# Autodesk Inventor assembly: Camera_Mount_Assembly
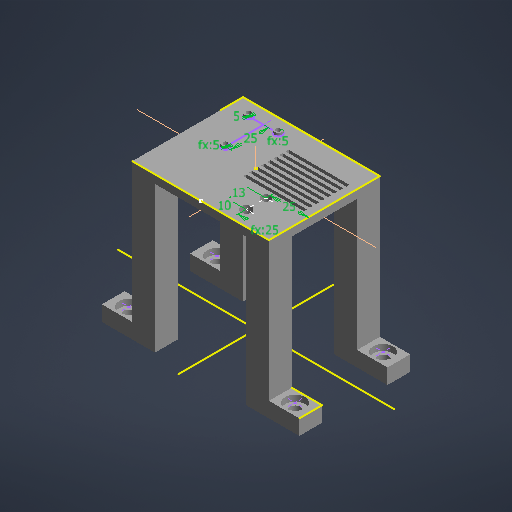
[picture p0: Inventor's stored thumbnail of the model, 512x512]
Saved by Autodesk Inventor 2027 (Build 310192000, 192)
## iProperties
Part Number: Camera_Mount_Assembly
Document SubType Name: Assembly
Designer: Jacob Parker
Author: Jacob Parker
## Documents named in this file (5)
- C:\Users\Jacob Parker\GitHub\FUSE-Head\system_development\Pintail\v0.1.3\CAD\Camera_Mount_Assembly.iam
- C:\Users\Jacob Parker\Documents\Thermal_Camera.ipt
- C:\Users\Jacob Parker\Documents\Thermal_Camera_Bracket.ipt
- C:\Users\Jacob Parker\Documents\Thermal_Optical_Camera_Bracket.ipt
- C:\Users\Jacob Parker\Documents\table.ipt
## Components (5 placed, 4 different names)
1. Thermal_Camera:1 — Rotational:1, Angle:1
2. Thermal_Camera_Bracket:1 — Mate:1, Rotational:1, Angle:1
3. Thermal_Optical_Camera_Bracket:1 — Mate:2, Rotational:2
4. table:1 — Mate:1, Mate:2
5. Thermal_Camera:2 — Rotational:2
## Relationships (5: Mate 2, RevoluteJoint 2, Angle 1)
- Mate:1: Thermal_Camera_Bracket:1 ↔ table:1
- Mate:2: Thermal_Optical_Camera_Bracket:1 ↔ table:1
- Rotational:1 [RevoluteJoint]: Thermal_Camera:1 ↔ Thermal_Camera_Bracket:1
- Angle:1 (0 deg): Thermal_Camera:1 ↔ Thermal_Camera_Bracket:1
- Rotational:2 [RevoluteJoint]: Thermal_Optical_Camera_Bracket:1 ↔ Thermal_Camera:2
